# Autodesk Inventor assembly: Roda Mecanum Wheel
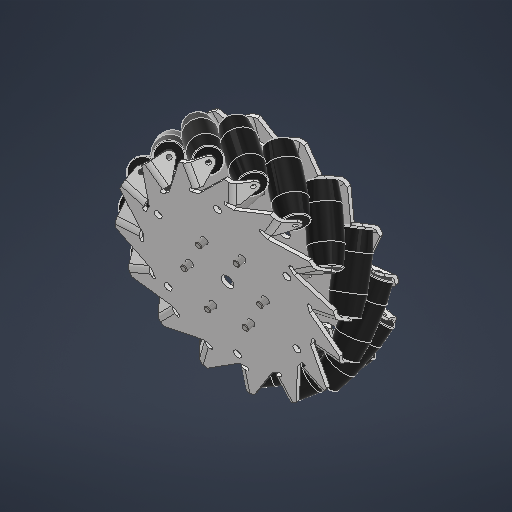
[picture p0: Inventor's stored thumbnail of the model, 512x512]
Saved by Autodesk Inventor 2026.2 (Build 302298010, 298A)
## iProperties
Created: 2026-11-18
Part Number: Roda Mecanum Wheel
Document SubType Name: Weldment
Designer: Administrator
Weld Material: Welded Aluminum-6061
Author: Administrator
## Documents named in this file (4)
- C:\Users\Administrator\Documents\UKM\ABU Robocoon\2027\Robot BR\Roda Mecanum Wheel.iam
- C:\Users\Administrator\Documents\UKM\ABU Robocoon\2027\Robot BR\Roller mecanum.ipt
- C:\Users\Administrator\Documents\UKM\ABU Robocoon\2027\Robot BR\Pelk.ipt
- C:\Users\Administrator\Documents\Inventor\Content Center Files\R2026\en-US\AS 1427(05)\AS 1427 - M4 x 50(5) II.ipt
## Components (23 placed, 3 different names)
1. Roller mecanum:1 — Mate:6, Mate:7
2. Pelk:1 — Insert:4, Insert:11, Insert:12, Insert:13, Insert:14, Insert:15, Mate:5, Mate:6, Mate:8, Mate:9, Mate:10, Mate:11, Mate:16, Mate:20, Mate:21, Mate:22, Mate:23, Mate:26, Mate:28, Mate:30, Mate:33
3. Roller mecanum:2 — Mate:4, Mate:5
4. Pelk:2 — Mate:1, Mate:2, Mate:3, Mate:4, Mate:7, Mate:12, Mate:13, Mate:14, Mate:15, Mate:17, Mate:18, Mate:19, Mate:24, Mate:25, Mate:27, Mate:29, Mate:31, Mate:32
5. AS 1427 H - Metric M4 x 50:1 — Insert:4
6. AS 1427 H - Metric M4 x 50:8 — Insert:11, Mate:3
7. AS 1427 H - Metric M4 x 50:9 — Insert:12, Mate:2
8. AS 1427 H - Metric M4 x 50:10 — Insert:13
9. AS 1427 H - Metric M4 x 50:11 — Insert:14, Mate:1
10. AS 1427 H - Metric M4 x 50:12 — Insert:15
11. Roller mecanum:3 — Mate:8, Mate:12
12. Roller mecanum:4 — Mate:11, Mate:15
13. Roller mecanum:5 — Mate:10, Mate:14
14. Roller mecanum:6 — Mate:16, Mate:17
15. Roller mecanum:7 — Mate:26, Mate:27
16. Roller mecanum:8 — Mate:23, Mate:25
17. Roller mecanum:9 — Mate:19, Mate:20
18. Roller mecanum:10 — Mate:9, Mate:13
19. Roller mecanum:11 — Mate:28, Mate:29
20. Roller mecanum:12 — Mate:30, Mate:31
21. Roller mecanum:13 — Mate:18, Mate:21
22. Roller mecanum:14 — Mate:22, Mate:24
23. Roller mecanum:15 — Mate:32, Mate:33
## Relationships (39: Mate 33, Insert 6)
- Insert:4: Pelk:1 ↔ AS 1427 H - Metric M4 x 50:1
- Insert:11: Pelk:1 ↔ AS 1427 H - Metric M4 x 50:8
- Insert:12: Pelk:1 ↔ AS 1427 H - Metric M4 x 50:9
- Insert:13: Pelk:1 ↔ AS 1427 H - Metric M4 x 50:10
- Insert:14: Pelk:1 ↔ AS 1427 H - Metric M4 x 50:11
- Insert:15: Pelk:1 ↔ AS 1427 H - Metric M4 x 50:12
- Mate:1: Pelk:2 ↔ AS 1427 H - Metric M4 x 50:11
- Mate:2: Pelk:2 ↔ AS 1427 H - Metric M4 x 50:9
- Mate:3: Pelk:2 ↔ AS 1427 H - Metric M4 x 50:8
- Mate:4: Roller mecanum:2 ↔ Pelk:2
- Mate:5: Pelk:1 ↔ Roller mecanum:2
- Mate:6: Roller mecanum:1 ↔ Pelk:1
- Mate:7: Roller mecanum:1 ↔ Pelk:2
- Mate:8: Pelk:1 ↔ Roller mecanum:3
- Mate:9: Pelk:1 ↔ Roller mecanum:10
- Mate:10: Pelk:1 ↔ Roller mecanum:5
- Mate:11: Pelk:1 ↔ Roller mecanum:4
- Mate:12: Pelk:2 ↔ Roller mecanum:3
- Mate:13: Pelk:2 ↔ Roller mecanum:10
- Mate:14: Pelk:2 ↔ Roller mecanum:5
- Mate:15: Pelk:2 ↔ Roller mecanum:4
- Mate:16: Pelk:1 ↔ Roller mecanum:6
- Mate:17: Pelk:2 ↔ Roller mecanum:6
- Mate:18: Pelk:2 ↔ Roller mecanum:13
- Mate:19: Pelk:2 ↔ Roller mecanum:9
- Mate:20: Pelk:1 ↔ Roller mecanum:9
- Mate:21: Pelk:1 ↔ Roller mecanum:13
- Mate:22: Pelk:1 ↔ Roller mecanum:14
- Mate:23: Pelk:1 ↔ Roller mecanum:8
- Mate:24: Pelk:2 ↔ Roller mecanum:14
- Mate:25: Pelk:2 ↔ Roller mecanum:8
- Mate:26: Pelk:1 ↔ Roller mecanum:7
- Mate:27: Pelk:2 ↔ Roller mecanum:7
- Mate:28: Pelk:1 ↔ Roller mecanum:11
- Mate:29: Pelk:2 ↔ Roller mecanum:11
- Mate:30: Pelk:1 ↔ Roller mecanum:12
- Mate:31: Pelk:2 ↔ Roller mecanum:12
- Mate:32: Pelk:2 ↔ Roller mecanum:15
- Mate:33: Pelk:1 ↔ Roller mecanum:15
